# Autodesk Inventor assembly: end-effector
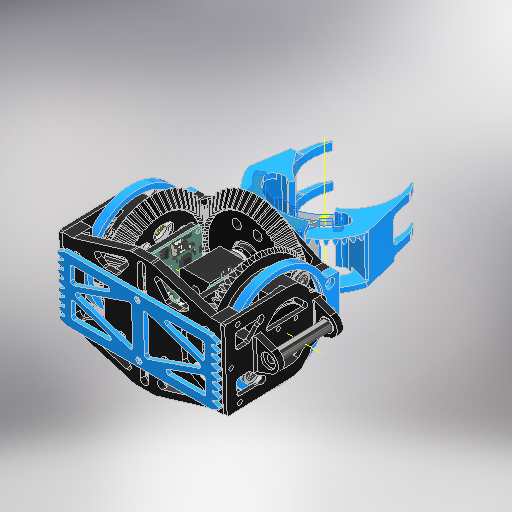
[picture p0: Inventor's stored thumbnail of the model, 512x512]
Saved by Autodesk Inventor 2025.3 (Build 293356030, 356C)
## iProperties
Created: 2026-05-04
Part Number: end-effector
Document SubType Name: Assembly
Designer: ibuki_ono
Author: ibuki_ono
## Documents named in this file (27)
- C:\Users\ibuki_ono\Documents\hobby\rogiken\catchrobo\2026_CAD\Hardware_2026\Inventor\End-Effector\end-effector.iam
- C:\Users\ibuki_ono\Documents\hobby\rogiken\catchrobo\2026_CAD\Hardware_2026\Inventor\End-Effector\2204_260kv-motor.iam
- C:\Users\ibuki_ono\Documents\hobby\rogiken\catchrobo\2026_CAD\Hardware_2026\Inventor\End-Effector\UDP_w5500\UDP_w5500\UDP_w5500.iam
- C:\Users\ibuki_ono\Documents\hobby\rogiken\catchrobo\2026_CAD\Hardware_2026\Inventor\End-Effector\harmonic.iam
- C:\Users\ibuki_ono\Documents\hobby\rogiken\catchrobo\2026_CAD\Hardware_2026\Inventor\End-Effector\SFL676ZZ.ipt
- C:\Users\ibuki_ono\Documents\hobby\rogiken\catchrobo\2026_CAD\Hardware_2026\Inventor\End-Effector\bearing-5-13.ipt
- C:\Users\ibuki_ono\Documents\hobby\rogiken\catchrobo\2026_CAD\Hardware_2026\Inventor\End-Effector\center.ipt
- C:\Users\ibuki_ono\Documents\hobby\rogiken\catchrobo\2026_CAD\Hardware_2026\Inventor\End-Effector\center-half.ipt
- C:\Users\ibuki_ono\Documents\hobby\rogiken\catchrobo\2026_CAD\Hardware_2026\Inventor\End-Effector\unbrella\main-gear\デザイン アクセラレータ\かさ歯車21.ipt
- C:\Users\ibuki_ono\Documents\hobby\rogiken\catchrobo\2026_CAD\Hardware_2026\Inventor\End-Effector\hand-gear\hand-gear\デザイン アクセラレータ\gear-side1.ipt
- C:\Users\ibuki_ono\Documents\hobby\rogiken\catchrobo\2026_CAD\Hardware_2026\Inventor\End-Effector\hand-gear\hand-gear\デザイン アクセラレータ\かさ歯車11.ipt
- C:\Users\ibuki_ono\Documents\hobby\rogiken\catchrobo\2026_CAD\Hardware_2026\Inventor\End-Effector\feetech-sts3215.ipt
- C:\Users\ibuki_ono\Documents\hobby\rogiken\catchrobo\2026_CAD\Hardware_2026\Inventor\End-Effector\feetech_servo-hone.ipt
- C:\Users\ibuki_ono\Documents\hobby\rogiken\catchrobo\2026_CAD\Hardware_2026\Inventor\End-Effector\3D_upper-fix.ipt
- C:\Users\ibuki_ono\Documents\hobby\rogiken\catchrobo\2026_CAD\Hardware_2026\Inventor\End-Effector\IR_camera.ipt
- C:\Users\ibuki_ono\Documents\hobby\rogiken\catchrobo\2026_CAD\Hardware_2026\Inventor\End-Effector\bearing-20-27.ipt
- C:\Users\ibuki_ono\Documents\hobby\rogiken\catchrobo\2026_CAD\Hardware_2026\Inventor\End-Effector\3D_motor-shaft.ipt
- C:\Users\ibuki_ono\Documents\hobby\rogiken\catchrobo\2026_CAD\Hardware_2026\Inventor\End-Effector\bearing-50-62.ipt
- C:\Users\ibuki_ono\Documents\hobby\rogiken\catchrobo\2026_CAD\Hardware_2026\Inventor\End-Effector\3D_bearing-holder.ipt
- C:\Users\ibuki_ono\Documents\hobby\rogiken\catchrobo\2026_CAD\Hardware_2026\Inventor\End-Effector\SZV4-12.ipt
- C:\Users\ibuki_ono\Documents\hobby\rogiken\catchrobo\2026_CAD\Hardware_2026\Inventor\End-Effector\3D_loader-pitch.ipt
- C:\Users\ibuki_ono\Documents\hobby\rogiken\catchrobo\2026_CAD\Hardware_2026\Inventor\End-Effector\3D_end-top.ipt
- C:\Users\ibuki_ono\Documents\hobby\rogiken\catchrobo\2026_CAD\Hardware_2026\Inventor\End-Effector\AR8.0_M5-40mm.ipt
- C:\Users\ibuki_ono\Documents\hobby\rogiken\catchrobo\2026_CAD\Hardware_2026\Inventor\top_links\AP3.0_rack-timing.ipt
- C:\Users\ibuki_ono\Documents\hobby\rogiken\catchrobo\2026_CAD\Hardware_2026\Inventor\End-Effector\C-SE692ZZ.ipt
- C:\Users\ibuki_ono\Documents\hobby\rogiken\catchrobo\2026_CAD\Hardware_2026\Inventor\End-Effector\AP5.0_servo-mount_bottom.ipt
- C:\Users\ibuki_ono\Documents\hobby\rogiken\catchrobo\2026_CAD\Hardware_2026\Inventor\End-Effector\STM32-TTL\UDP_w5500\UDP_w5500.iam
## Components (46 placed, 24 different names)
1. 2204_260kv-motor:1 [sub-assembly] — メイト:1, 挿入:44, 挿入:45
2. UDP_w5500:1 [sub-assembly] — 角度:1, 挿入:48, 挿入:49
3. harmonic:1 [sub-assembly] — メイト:1, メイト:2, 角度:1, 角度:3, メイト:19, メイト:21, メイト:22, 挿入:40, 挿入:41, 挿入:42, 挿入:43, 挿入:44, 挿入:45, 挿入:50, 挿入:51, 挿入:54
4. SFL676ZZ:1 — 挿入:2
5. bearing-5-13:1 — 挿入:4, 挿入:6
6. bearing-5-13:2 — 挿入:3, 挿入:5
7. center:1 — 挿入:2, 挿入:3, 挿入:4
8. center-half:1 — 挿入:5, 挿入:6
9. かさ歯車2:1 — メイト:5, メイト:14, 挿入:13, 挿入:14, 挿入:15, 挿入:16, メイト:15, メイト:30
10. かさ歯車2:2 — 角度:2, メイト:8, メイト:9
11. かさ歯車1:1 — 角度:2, メイト:15
12. かさ歯車2:3 — メイト:8, メイト:9, メイト:12
13. 3D_upper-fix:1 — メイト:12, 挿入:10, 挿入:11, 挿入:13, 挿入:14, 挿入:15, 挿入:19
14. IR_camera:1 — 挿入:10, 挿入:11
15. feetech-sts3215:1 — 挿入:12, 角度:3, 挿入:58, 挿入:59
16. feetech_servo-hone:1 — 挿入:12, メイト:14, メイト:30
17. bearing-20-27:1 — 挿入:16, メイト:17
18. 3D_motor-shaft:1 — メイト:17
19. bearing-50-62:1 — 挿入:19, 挿入:30
20. 2204_260kv-motor:2 [sub-assembly] — 挿入:46, 挿入:47
21. UDP_w5500:2 [sub-assembly] — 挿入:52, 挿入:53
22. harmonic:2 [sub-assembly] — メイト:19, 挿入:36, 挿入:37, 挿入:38, 挿入:39, 挿入:46, 挿入:47, メイト:23, メイト:24, フラッシュ:5, フラッシュ:6, 挿入:55
23. SFL676ZZ:2
24. bearing-5-13:3
25. bearing-5-13:4
26. center:2
27. center-half:2
28. 3D_bearing-holder:1 — 挿入:30, フラッシュ:4, 挿入:32, 挿入:33, 挿入:34, 挿入:35
29. SZV4-12:1 — 挿入:36
30. 3D_loader-pitch:1 — フラッシュ:4, 挿入:32, 挿入:33, メイト:23
31. 3D_loader-pitch:2 — 挿入:34, 挿入:35, メイト:21, メイト:22
32. SZV4-12:2 — 挿入:37
33. SZV4-12:3 — 挿入:38
34. SZV4-12:4 — 挿入:39
35. SZV4-12:5 — 挿入:40
36. SZV4-12:6 — 挿入:43
37. SZV4-12:7 — 挿入:41
38. SZV4-12:8 — 挿入:42
39. 3D_end-top:1 — メイト:24, フラッシュ:5, フラッシュ:6, 挿入:48, 挿入:49, 挿入:50, 挿入:51, 挿入:52, 挿入:53, メイト:25, メイト:26, メイト:27, メイト:28, メイト:29, 挿入:60, 挿入:61
40. AR8.0_M5-40mm:1 — 挿入:54
41. AR8.0_M5-40mm:2 — 挿入:55
42. AP3.0_rack-timing:1 — メイト:25, メイト:26, メイト:27, メイト:28, メイト:29, 挿入:56, 挿入:57
43. C-SE692ZZ:1 — 挿入:56
44. C-SE692ZZ:2 — 挿入:57
45. AP5.0_servo-mount_bottom:1 — 挿入:58, 挿入:59
46. UDP_w5500:3 [sub-assembly] — 挿入:60, 挿入:61
## Relationships (77: Insert 49, Mate 21, Angle 4, Flush 3)
- メイト:1 [Mate]: 2204_260kv-motor:1 ↔ harmonic:1
- 挿入:2 [Insert]: SFL676ZZ:1 ↔ center:1
- 挿入:3 [Insert]: bearing-5-13:2 ↔ center:1
- 挿入:4 [Insert]: bearing-5-13:1 ↔ center:1
- 挿入:5 [Insert]: bearing-5-13:2 ↔ center-half:1
- 挿入:6 [Insert]: bearing-5-13:1 ↔ center-half:1
- メイト:2 [Mate]: harmonic:1
- メイト:5 [Mate]: かさ歯車2:1
- 角度:1 [Angle] (180 deg): UDP_w5500:1 ↔ harmonic:1
- 角度:2 [Angle] (90 deg): かさ歯車2:2 ↔ かさ歯車1:1
- メイト:8 [Mate]: かさ歯車2:2 ↔ かさ歯車2:3
- メイト:9 [Mate]: かさ歯車2:2 ↔ かさ歯車2:3
- メイト:12 [Mate]: かさ歯車2:3 ↔ 3D_upper-fix:1
- 挿入:10 [Insert]: 3D_upper-fix:1 ↔ IR_camera:1
- 挿入:11 [Insert]: 3D_upper-fix:1 ↔ IR_camera:1
- 挿入:12 [Insert]: feetech-sts3215:1 ↔ feetech_servo-hone:1
- メイト:14 [Mate]: かさ歯車2:1 ↔ feetech_servo-hone:1
- 挿入:13 [Insert]: かさ歯車2:1 ↔ 3D_upper-fix:1
- 挿入:14 [Insert]: かさ歯車2:1 ↔ 3D_upper-fix:1
- 挿入:15 [Insert]: かさ歯車2:1 ↔ 3D_upper-fix:1
- 挿入:16 [Insert]: かさ歯車2:1 ↔ bearing-20-27:1
- メイト:15 [Mate]: かさ歯車2:1 ↔ かさ歯車1:1
- 角度:3 [Angle] (0 deg): harmonic:1 ↔ feetech-sts3215:1
- メイト:17 [Mate]: bearing-20-27:1 ↔ 3D_motor-shaft:1
- 挿入:19 [Insert]: 3D_upper-fix:1 ↔ bearing-50-62:1
- [Mate]: 2204_260kv-motor:2 ↔ harmonic:2
- [Insert]: SFL676ZZ:2 ↔ center:2
- [Insert]: bearing-5-13:4 ↔ center:2
- [Insert]: bearing-5-13:3 ↔ center:2
- [Insert]: bearing-5-13:4 ↔ center-half:2
- [Insert]: bearing-5-13:3 ↔ center-half:2
- [Angle] (180 deg): UDP_w5500:2 ↔ harmonic:2
- メイト:19 [Mate]: harmonic:1 ↔ harmonic:2
- 挿入:30 [Insert]: bearing-50-62:1 ↔ 3D_bearing-holder:1
- フラッシュ:4 [Flush]: 3D_bearing-holder:1 ↔ 3D_loader-pitch:1
- 挿入:32 [Insert]: 3D_bearing-holder:1 ↔ 3D_loader-pitch:1
- 挿入:33 [Insert]: 3D_bearing-holder:1 ↔ 3D_loader-pitch:1
- 挿入:34 [Insert]: 3D_bearing-holder:1 ↔ 3D_loader-pitch:2
- 挿入:35 [Insert]: 3D_bearing-holder:1 ↔ 3D_loader-pitch:2
- メイト:21 [Mate] (9 mm): harmonic:1 ↔ 3D_loader-pitch:2
- 挿入:36 [Insert]: harmonic:2 ↔ SZV4-12:1
- 挿入:37 [Insert]: harmonic:2 ↔ SZV4-12:2
- 挿入:38 [Insert]: harmonic:2 ↔ SZV4-12:3
- 挿入:39 [Insert]: harmonic:2 ↔ SZV4-12:4
- メイト:22 [Mate]: harmonic:1 ↔ 3D_loader-pitch:2
- 挿入:40 [Insert]: harmonic:1 ↔ SZV4-12:5
- 挿入:41 [Insert]: harmonic:1 ↔ SZV4-12:7
- 挿入:42 [Insert]: harmonic:1 ↔ SZV4-12:8
- 挿入:43 [Insert]: harmonic:1 ↔ SZV4-12:6
- 挿入:44 [Insert]: 2204_260kv-motor:1 ↔ harmonic:1
- 挿入:45 [Insert]: 2204_260kv-motor:1 ↔ harmonic:1
- 挿入:46 [Insert]: 2204_260kv-motor:2 ↔ harmonic:2
- 挿入:47 [Insert]: 2204_260kv-motor:2 ↔ harmonic:2
- メイト:23 [Mate] (9 mm): harmonic:2 ↔ 3D_loader-pitch:1
- メイト:24 [Mate]: harmonic:2 ↔ 3D_end-top:1
- フラッシュ:5 [Flush]: harmonic:2 ↔ 3D_end-top:1
- フラッシュ:6 [Flush]: harmonic:2 ↔ 3D_end-top:1
- 挿入:48 [Insert]: UDP_w5500:1 ↔ 3D_end-top:1
- 挿入:49 [Insert]: UDP_w5500:1 ↔ 3D_end-top:1
- 挿入:50 [Insert]: harmonic:1 ↔ 3D_end-top:1
- 挿入:51 [Insert]: harmonic:1 ↔ 3D_end-top:1
- 挿入:52 [Insert]: UDP_w5500:2 ↔ 3D_end-top:1
- 挿入:53 [Insert]: UDP_w5500:2 ↔ 3D_end-top:1
- 挿入:54 [Insert]: harmonic:1 ↔ AR8.0_M5-40mm:1
- 挿入:55 [Insert]: harmonic:2 ↔ AR8.0_M5-40mm:2
- メイト:25 [Mate]: 3D_end-top:1 ↔ AP3.0_rack-timing:1
- メイト:26 [Mate] (3.1 mm): 3D_end-top:1 ↔ AP3.0_rack-timing:1
- メイト:27 [Mate] (3.1 mm): 3D_end-top:1 ↔ AP3.0_rack-timing:1
- メイト:28 [Mate]: 3D_end-top:1 ↔ AP3.0_rack-timing:1
- メイト:29 [Mate]: 3D_end-top:1 ↔ AP3.0_rack-timing:1
- 挿入:56 [Insert]: AP3.0_rack-timing:1 ↔ C-SE692ZZ:1
- 挿入:57 [Insert]: AP3.0_rack-timing:1 ↔ C-SE692ZZ:2
- 挿入:58 [Insert]: feetech-sts3215:1 ↔ AP5.0_servo-mount_bottom:1
- 挿入:59 [Insert]: feetech-sts3215:1 ↔ AP5.0_servo-mount_bottom:1
- メイト:30 [Mate]: かさ歯車2:1 ↔ feetech_servo-hone:1
- 挿入:60 [Insert]: 3D_end-top:1 ↔ UDP_w5500:3
- 挿入:61 [Insert]: 3D_end-top:1 ↔ UDP_w5500:3
## Named parameters: d58_d5 = 0 mm, d59_d6 = 0 mm, d60_d7 = 0 mm, d61_d10 = 0 mm, d62_d11 = 0 mm, d63_d16 = 180 deg, d64_d3 = 0 mm
